# Autodesk Inventor assembly: com_board
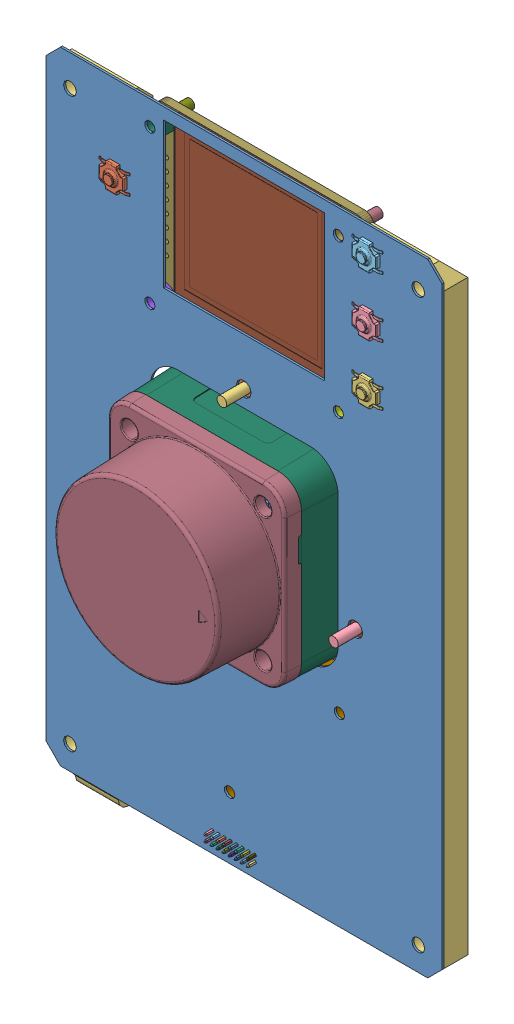
[picture p0: shaded view drawn from the shape stored in the file]
Saved by Autodesk Inventor 2025 (Build 290162000, 162)
## iProperties
Created: 2026-10-25
Part Number: com_board
Document SubType Name: Assembly
Designer: Leva
Author: Leva
## Documents named in this file (3)
- C:\Users\Leva\Documents\Git\TheseusV2_Maze\Construction\Theseus_v2\com_board.iam
- C:\Users\Leva\Documents\Git\TheseusV2_Maze\Schematic\TSE_commutation_board\TSE_commutation_board.ipt
- C:\Users\Leva\Documents\Git\TheseusV2_Maze\Construction\Theseus_v2\commutation_board\cap.ipt
## Components (2 placed, 2 different names)
1. TSE_commutation_board:1 — Совмещение:1, Совмещение:2, Совмещение:3
2. cap:1 — Совмещение:1, Совмещение:2, Совмещение:3
## Relationships (3: Mate 3)
- Совмещение:1 [Mate]: TSE_commutation_board:1 ↔ cap:1
- Совмещение:2 [Mate]: TSE_commutation_board:1 ↔ cap:1
- Совмещение:3 [Mate]: TSE_commutation_board:1 ↔ cap:1
